# Autodesk Inventor assembly: Ensamblaje7
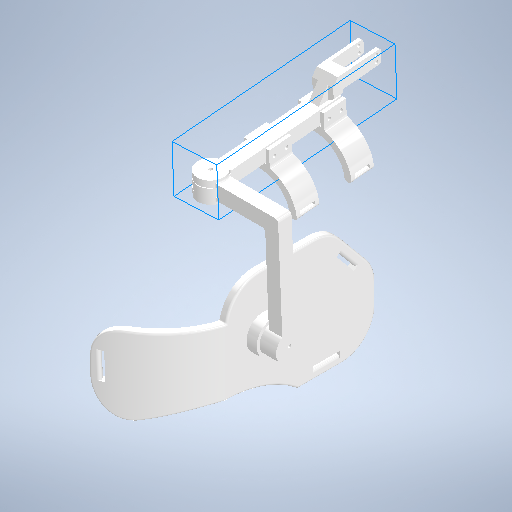
[picture p0: Inventor's stored thumbnail of the model, 512x512]
Saved by Autodesk Inventor 2025.1 (Build 291241000, 241)
## iProperties
Created: 2025-05-10
Part Number: Ensamblaje7
Document SubType Name: Assembly
Designer: HP
Author: HP
## Documents named in this file (6)
- C:\Users\HP\Desktop\PROYECTO DIBUJO MECATRONICO\Ensamblaje7.iam
- C:\Users\HP\Desktop\PROYECTO DIBUJO MECATRONICO\APOYO ESPALDAR.ipt
- C:\Users\HP\Desktop\PROYECTO DIBUJO MECATRONICO\Pieza1.ipt
- C:\Users\HP\Desktop\PROYECTO DIBUJO MECATRONICO\CONECTOR ROTATIVO.ipt
- C:\Users\HP\Desktop\PROYECTO DIBUJO MECATRONICO\SOPORTE SUPERIOR.ipt
- C:\Users\HP\Desktop\PROYECTO DIBUJO MECATRONICO\CINTA 1.ipt
## Components (6 placed, 5 different names)
1. APOYO ESPALDAR:1 — De rotación:1
2. Pieza1:1
3. CONECTOR ROTATIVO:1 — De rotación:1, De rotación:2
4. SOPORTE SUPERIOR:1 — De rotación:2, Rígido:1, Rígido:2
5. CINTA 1:1 — Rígido:2
6. CINTA 1:2 — Rígido:1
## Relationships (4: RevoluteJoint 2, WeldJoint 2)
- De rotación:1 [RevoluteJoint]: APOYO ESPALDAR:1 ↔ CONECTOR ROTATIVO:1
- De rotación:2 [RevoluteJoint]: CONECTOR ROTATIVO:1 ↔ SOPORTE SUPERIOR:1
- Rígido:1 [WeldJoint]: SOPORTE SUPERIOR:1 ↔ CINTA 1:2
- Rígido:2 [WeldJoint]: SOPORTE SUPERIOR:1 ↔ CINTA 1:1
